# Autodesk Inventor assembly: V6_Engine_Assembly
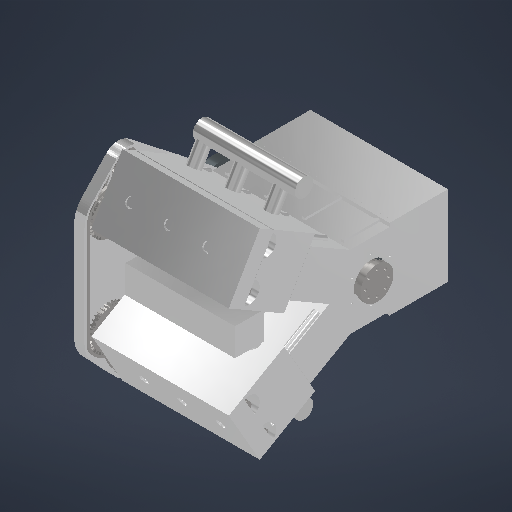
[picture p0: Inventor's stored thumbnail of the model, 512x512]
Saved by Autodesk Inventor 2027.1 (Build 311270010, 270A)
## iProperties
Created: 2026-10-17
Part Number: V6_Engine_Assembly
Document SubType Name: Assembly
Designer: kashyap
Author: kashyap
## Documents named in this file (14)
- C:\Users\kashyap\Documents\V6_2GR\V6_Engine_Assembly.iam
- C:\Users\kashyap\Documents\V6_2GR\V6_Engine_Block.ipt
- C:\Users\kashyap\Documents\V6_2GR\V6_Main_Bearing_Cap.ipt
- C:\Users\kashyap\Documents\V6_2GR\Main_Shell_Upper.ipt
- C:\Users\kashyap\Documents\V6_2GR\Main_Shell_Lower.ipt
- C:\Users\kashyap\Documents\V6_2GR\V6_Crankshaft.ipt
- C:\Users\kashyap\Documents\V6_2GR\Con_Rod.ipt
- C:\Users\kashyap\Documents\V6_2GR\Rod_Cap.ipt
- C:\Users\kashyap\Documents\V6_2GR\Rod_Shell_Upper.ipt
- C:\Users\kashyap\Documents\V6_2GR\Rod_Shell_Lower.ipt
- C:\Users\kashyap\Documents\V6_2GR\Piston.ipt
- C:\Users\kashyap\Documents\V6_2GR\Wrist_Pin.ipt
- C:\Users\kashyap\Documents\V6_2GR\V6_Heads_Valvetrain.iam
- C:\Users\kashyap\Documents\V6_2GR\V6_Externals.iam
## Components (52 placed, 52 different names)
1. Block — Main_Cap_1_Flush_X, Main_Cap_1_Flush_Y, Main_Cap_1_Flush_Z, Main_Shell_Upper_1_Flush_X, Main_Shell_Upper_1_Flush_Y, Main_Shell_Upper_1_Flush_Z, Main_Shell_Lower_1_Flush_X, Main_Shell_Lower_1_Flush_Y, Main_Shell_Lower_1_Flush_Z, Main_Cap_2_Flush_X, Main_Cap_2_Flush_Y, Main_Cap_2_Flush_Z, Main_Shell_Upper_2_Flush_X, Main_Shell_Upper_2_Flush_Y, Main_Shell_Upper_2_Flush_Z, Main_Shell_Lower_2_Flush_X, Main_Shell_Lower_2_Flush_Y, Main_Shell_Lower_2_Flush_Z, Main_Cap_3_Flush_X, Main_Cap_3_Flush_Y, Main_Cap_3_Flush_Z, Main_Shell_Upper_3_Flush_X, Main_Shell_Upper_3_Flush_Y, Main_Shell_Upper_3_Flush_Z, Main_Shell_Lower_3_Flush_X, Main_Shell_Lower_3_Flush_Y, Main_Shell_Lower_3_Flush_Z, Main_Cap_4_Flush_X, Main_Cap_4_Flush_Y, Main_Cap_4_Flush_Z, Main_Shell_Upper_4_Flush_X, Main_Shell_Upper_4_Flush_Y, Main_Shell_Upper_4_Flush_Z, Main_Shell_Lower_4_Flush_X, Main_Shell_Lower_4_Flush_Y, Main_Shell_Lower_4_Flush_Z, Crank_on_Crankshaft_Axis, Crank_Axial_Flush, Crank_Angle_Drive, Piston_A1_on_Cylinder_Axis, Piston_B1_on_Cylinder_Axis, Piston_A2_on_Cylinder_Axis, Piston_B2_on_Cylinder_Axis, Piston_A3_on_Cylinder_Axis, Piston_B3_on_Cylinder_Axis, Heads_Valvetrain_Flush_X, Heads_Valvetrain_Flush_Y, Heads_Valvetrain_Flush_Z, Externals_Flush_X, Externals_Flush_Y, Externals_Flush_Z
2. Main_Cap_1 — Main_Cap_1_Flush_X, Main_Cap_1_Flush_Y, Main_Cap_1_Flush_Z
3. Main_Shell_Upper_1 — Main_Shell_Upper_1_Flush_X, Main_Shell_Upper_1_Flush_Y, Main_Shell_Upper_1_Flush_Z
4. Main_Shell_Lower_1 — Main_Shell_Lower_1_Flush_X, Main_Shell_Lower_1_Flush_Y, Main_Shell_Lower_1_Flush_Z
5. Main_Cap_2 — Main_Cap_2_Flush_X, Main_Cap_2_Flush_Y, Main_Cap_2_Flush_Z
6. Main_Shell_Upper_2 — Main_Shell_Upper_2_Flush_X, Main_Shell_Upper_2_Flush_Y, Main_Shell_Upper_2_Flush_Z
7. Main_Shell_Lower_2 — Main_Shell_Lower_2_Flush_X, Main_Shell_Lower_2_Flush_Y, Main_Shell_Lower_2_Flush_Z
8. Main_Cap_3 — Main_Cap_3_Flush_X, Main_Cap_3_Flush_Y, Main_Cap_3_Flush_Z
9. Main_Shell_Upper_3 — Main_Shell_Upper_3_Flush_X, Main_Shell_Upper_3_Flush_Y, Main_Shell_Upper_3_Flush_Z
10. Main_Shell_Lower_3 — Main_Shell_Lower_3_Flush_X, Main_Shell_Lower_3_Flush_Y, Main_Shell_Lower_3_Flush_Z
11. Main_Cap_4 — Main_Cap_4_Flush_X, Main_Cap_4_Flush_Y, Main_Cap_4_Flush_Z
12. Main_Shell_Upper_4 — Main_Shell_Upper_4_Flush_X, Main_Shell_Upper_4_Flush_Y, Main_Shell_Upper_4_Flush_Z
13. Main_Shell_Lower_4 — Main_Shell_Lower_4_Flush_X, Main_Shell_Lower_4_Flush_Y, Main_Shell_Lower_4_Flush_Z
14. Crankshaft — Crank_on_Crankshaft_Axis, Crank_Axial_Flush, Crank_Angle_Drive, Rod_A1_on_Crankpin, Rod_A1_Mid_Flush, Rod_B1_on_Crankpin, Rod_B1_Mid_Flush, Rod_A2_on_Crankpin, Rod_A2_Mid_Flush, Rod_B2_on_Crankpin, Rod_B2_Mid_Flush, Rod_A3_on_Crankpin, Rod_A3_Mid_Flush, Rod_B3_on_Crankpin, Rod_B3_Mid_Flush
15. Rod_A1 — Rod_A1_on_Crankpin, Rod_A1_Mid_Flush, Rod_A1_SmallEnd_on_Pin_Axis, Rod_Cap_A1_Flush_X, Rod_Cap_A1_Flush_Y, Rod_Cap_A1_Flush_Z, Rod_Shell_Upper_A1_Flush_X, Rod_Shell_Upper_A1_Flush_Y, Rod_Shell_Upper_A1_Flush_Z, Rod_Shell_Lower_A1_Flush_X, Rod_Shell_Lower_A1_Flush_Y, Rod_Shell_Lower_A1_Flush_Z
16. Rod_Cap_A1 — Rod_Cap_A1_Flush_X, Rod_Cap_A1_Flush_Y, Rod_Cap_A1_Flush_Z
17. Rod_Shell_Upper_A1 — Rod_Shell_Upper_A1_Flush_X, Rod_Shell_Upper_A1_Flush_Y, Rod_Shell_Upper_A1_Flush_Z
18. Rod_Shell_Lower_A1 — Rod_Shell_Lower_A1_Flush_X, Rod_Shell_Lower_A1_Flush_Y, Rod_Shell_Lower_A1_Flush_Z
19. Piston_A1 — Piston_A1_on_Cylinder_Axis, Rod_A1_SmallEnd_on_Pin_Axis, Wrist_Pin_A1_Flush_X, Wrist_Pin_A1_Flush_Y, Wrist_Pin_A1_Flush_Z
20. Wrist_Pin_A1 — Wrist_Pin_A1_Flush_X, Wrist_Pin_A1_Flush_Y, Wrist_Pin_A1_Flush_Z
21. Rod_B1 — Rod_B1_on_Crankpin, Rod_B1_Mid_Flush, Rod_B1_SmallEnd_on_Pin_Axis, Rod_Cap_B1_Flush_X, Rod_Cap_B1_Flush_Y, Rod_Cap_B1_Flush_Z, Rod_Shell_Upper_B1_Flush_X, Rod_Shell_Upper_B1_Flush_Y, Rod_Shell_Upper_B1_Flush_Z, Rod_Shell_Lower_B1_Flush_X, Rod_Shell_Lower_B1_Flush_Y, Rod_Shell_Lower_B1_Flush_Z
22. Rod_Cap_B1 — Rod_Cap_B1_Flush_X, Rod_Cap_B1_Flush_Y, Rod_Cap_B1_Flush_Z
23. Rod_Shell_Upper_B1 — Rod_Shell_Upper_B1_Flush_X, Rod_Shell_Upper_B1_Flush_Y, Rod_Shell_Upper_B1_Flush_Z
24. Rod_Shell_Lower_B1 — Rod_Shell_Lower_B1_Flush_X, Rod_Shell_Lower_B1_Flush_Y, Rod_Shell_Lower_B1_Flush_Z
25. Piston_B1 — Piston_B1_on_Cylinder_Axis, Rod_B1_SmallEnd_on_Pin_Axis, Wrist_Pin_B1_Flush_X, Wrist_Pin_B1_Flush_Y, Wrist_Pin_B1_Flush_Z
26. Wrist_Pin_B1 — Wrist_Pin_B1_Flush_X, Wrist_Pin_B1_Flush_Y, Wrist_Pin_B1_Flush_Z
27. Rod_A2 — Rod_A2_on_Crankpin, Rod_A2_Mid_Flush, Rod_A2_SmallEnd_on_Pin_Axis, Rod_Cap_A2_Flush_X, Rod_Cap_A2_Flush_Y, Rod_Cap_A2_Flush_Z, Rod_Shell_Upper_A2_Flush_X, Rod_Shell_Upper_A2_Flush_Y, Rod_Shell_Upper_A2_Flush_Z, Rod_Shell_Lower_A2_Flush_X, Rod_Shell_Lower_A2_Flush_Y, Rod_Shell_Lower_A2_Flush_Z
28. Rod_Cap_A2 — Rod_Cap_A2_Flush_X, Rod_Cap_A2_Flush_Y, Rod_Cap_A2_Flush_Z
29. Rod_Shell_Upper_A2 — Rod_Shell_Upper_A2_Flush_X, Rod_Shell_Upper_A2_Flush_Y, Rod_Shell_Upper_A2_Flush_Z
30. Rod_Shell_Lower_A2 — Rod_Shell_Lower_A2_Flush_X, Rod_Shell_Lower_A2_Flush_Y, Rod_Shell_Lower_A2_Flush_Z
31. Piston_A2 — Piston_A2_on_Cylinder_Axis, Rod_A2_SmallEnd_on_Pin_Axis, Wrist_Pin_A2_Flush_X, Wrist_Pin_A2_Flush_Y, Wrist_Pin_A2_Flush_Z
32. Wrist_Pin_A2 — Wrist_Pin_A2_Flush_X, Wrist_Pin_A2_Flush_Y, Wrist_Pin_A2_Flush_Z
33. Rod_B2 — Rod_B2_on_Crankpin, Rod_B2_Mid_Flush, Rod_B2_SmallEnd_on_Pin_Axis, Rod_Cap_B2_Flush_X, Rod_Cap_B2_Flush_Y, Rod_Cap_B2_Flush_Z, Rod_Shell_Upper_B2_Flush_X, Rod_Shell_Upper_B2_Flush_Y, Rod_Shell_Upper_B2_Flush_Z, Rod_Shell_Lower_B2_Flush_X, Rod_Shell_Lower_B2_Flush_Y, Rod_Shell_Lower_B2_Flush_Z
34. Rod_Cap_B2 — Rod_Cap_B2_Flush_X, Rod_Cap_B2_Flush_Y, Rod_Cap_B2_Flush_Z
35. Rod_Shell_Upper_B2 — Rod_Shell_Upper_B2_Flush_X, Rod_Shell_Upper_B2_Flush_Y, Rod_Shell_Upper_B2_Flush_Z
36. Rod_Shell_Lower_B2 — Rod_Shell_Lower_B2_Flush_X, Rod_Shell_Lower_B2_Flush_Y, Rod_Shell_Lower_B2_Flush_Z
37. Piston_B2 — Piston_B2_on_Cylinder_Axis, Rod_B2_SmallEnd_on_Pin_Axis, Wrist_Pin_B2_Flush_X, Wrist_Pin_B2_Flush_Y, Wrist_Pin_B2_Flush_Z
38. Wrist_Pin_B2 — Wrist_Pin_B2_Flush_X, Wrist_Pin_B2_Flush_Y, Wrist_Pin_B2_Flush_Z
39. Rod_A3 — Rod_A3_on_Crankpin, Rod_A3_Mid_Flush, Rod_A3_SmallEnd_on_Pin_Axis, Rod_Cap_A3_Flush_X, Rod_Cap_A3_Flush_Y, Rod_Cap_A3_Flush_Z, Rod_Shell_Upper_A3_Flush_X, Rod_Shell_Upper_A3_Flush_Y, Rod_Shell_Upper_A3_Flush_Z, Rod_Shell_Lower_A3_Flush_X, Rod_Shell_Lower_A3_Flush_Y, Rod_Shell_Lower_A3_Flush_Z
40. Rod_Cap_A3 — Rod_Cap_A3_Flush_X, Rod_Cap_A3_Flush_Y, Rod_Cap_A3_Flush_Z
41. Rod_Shell_Upper_A3 — Rod_Shell_Upper_A3_Flush_X, Rod_Shell_Upper_A3_Flush_Y, Rod_Shell_Upper_A3_Flush_Z
42. Rod_Shell_Lower_A3 — Rod_Shell_Lower_A3_Flush_X, Rod_Shell_Lower_A3_Flush_Y, Rod_Shell_Lower_A3_Flush_Z
43. Piston_A3 — Piston_A3_on_Cylinder_Axis, Rod_A3_SmallEnd_on_Pin_Axis, Wrist_Pin_A3_Flush_X, Wrist_Pin_A3_Flush_Y, Wrist_Pin_A3_Flush_Z
44. Wrist_Pin_A3 — Wrist_Pin_A3_Flush_X, Wrist_Pin_A3_Flush_Y, Wrist_Pin_A3_Flush_Z
45. Rod_B3 — Rod_B3_on_Crankpin, Rod_B3_Mid_Flush, Rod_B3_SmallEnd_on_Pin_Axis, Rod_Cap_B3_Flush_X, Rod_Cap_B3_Flush_Y, Rod_Cap_B3_Flush_Z, Rod_Shell_Upper_B3_Flush_X, Rod_Shell_Upper_B3_Flush_Y, Rod_Shell_Upper_B3_Flush_Z, Rod_Shell_Lower_B3_Flush_X, Rod_Shell_Lower_B3_Flush_Y, Rod_Shell_Lower_B3_Flush_Z
46. Rod_Cap_B3 — Rod_Cap_B3_Flush_X, Rod_Cap_B3_Flush_Y, Rod_Cap_B3_Flush_Z
47. Rod_Shell_Upper_B3 — Rod_Shell_Upper_B3_Flush_X, Rod_Shell_Upper_B3_Flush_Y, Rod_Shell_Upper_B3_Flush_Z
48. Rod_Shell_Lower_B3 — Rod_Shell_Lower_B3_Flush_X, Rod_Shell_Lower_B3_Flush_Y, Rod_Shell_Lower_B3_Flush_Z
49. Piston_B3 — Piston_B3_on_Cylinder_Axis, Rod_B3_SmallEnd_on_Pin_Axis, Wrist_Pin_B3_Flush_X, Wrist_Pin_B3_Flush_Y, Wrist_Pin_B3_Flush_Z
50. Wrist_Pin_B3 — Wrist_Pin_B3_Flush_X, Wrist_Pin_B3_Flush_Y, Wrist_Pin_B3_Flush_Z
51. Heads_Valvetrain [sub-assembly] — Heads_Valvetrain_Flush_X, Heads_Valvetrain_Flush_Y, Heads_Valvetrain_Flush_Z
52. Externals [sub-assembly] — Externals_Flush_X, Externals_Flush_Y, Externals_Flush_Z
## Relationships (141: Flush 121, Mate 19, Angle 1)
- Main_Cap_1_Flush_X [Flush]: Block ↔ Main_Cap_1
- Main_Cap_1_Flush_Y [Flush]: Block ↔ Main_Cap_1
- Main_Cap_1_Flush_Z [Flush]: Block ↔ Main_Cap_1
- Main_Shell_Upper_1_Flush_X [Flush]: Block ↔ Main_Shell_Upper_1
- Main_Shell_Upper_1_Flush_Y [Flush]: Block ↔ Main_Shell_Upper_1
- Main_Shell_Upper_1_Flush_Z [Flush]: Block ↔ Main_Shell_Upper_1
- Main_Shell_Lower_1_Flush_X [Flush]: Block ↔ Main_Shell_Lower_1
- Main_Shell_Lower_1_Flush_Y [Flush]: Block ↔ Main_Shell_Lower_1
- Main_Shell_Lower_1_Flush_Z [Flush]: Block ↔ Main_Shell_Lower_1
- Main_Cap_2_Flush_X [Flush]: Block ↔ Main_Cap_2
- Main_Cap_2_Flush_Y [Flush]: Block ↔ Main_Cap_2
- Main_Cap_2_Flush_Z [Flush]: Block ↔ Main_Cap_2
- Main_Shell_Upper_2_Flush_X [Flush]: Block ↔ Main_Shell_Upper_2
- Main_Shell_Upper_2_Flush_Y [Flush]: Block ↔ Main_Shell_Upper_2
- Main_Shell_Upper_2_Flush_Z [Flush]: Block ↔ Main_Shell_Upper_2
- Main_Shell_Lower_2_Flush_X [Flush]: Block ↔ Main_Shell_Lower_2
- Main_Shell_Lower_2_Flush_Y [Flush]: Block ↔ Main_Shell_Lower_2
- Main_Shell_Lower_2_Flush_Z [Flush]: Block ↔ Main_Shell_Lower_2
- Main_Cap_3_Flush_X [Flush]: Block ↔ Main_Cap_3
- Main_Cap_3_Flush_Y [Flush]: Block ↔ Main_Cap_3
- Main_Cap_3_Flush_Z [Flush]: Block ↔ Main_Cap_3
- Main_Shell_Upper_3_Flush_X [Flush]: Block ↔ Main_Shell_Upper_3
- Main_Shell_Upper_3_Flush_Y [Flush]: Block ↔ Main_Shell_Upper_3
- Main_Shell_Upper_3_Flush_Z [Flush]: Block ↔ Main_Shell_Upper_3
- Main_Shell_Lower_3_Flush_X [Flush]: Block ↔ Main_Shell_Lower_3
- Main_Shell_Lower_3_Flush_Y [Flush]: Block ↔ Main_Shell_Lower_3
- Main_Shell_Lower_3_Flush_Z [Flush]: Block ↔ Main_Shell_Lower_3
- Main_Cap_4_Flush_X [Flush]: Block ↔ Main_Cap_4
- Main_Cap_4_Flush_Y [Flush]: Block ↔ Main_Cap_4
- Main_Cap_4_Flush_Z [Flush]: Block ↔ Main_Cap_4
- Main_Shell_Upper_4_Flush_X [Flush]: Block ↔ Main_Shell_Upper_4
- Main_Shell_Upper_4_Flush_Y [Flush]: Block ↔ Main_Shell_Upper_4
- Main_Shell_Upper_4_Flush_Z [Flush]: Block ↔ Main_Shell_Upper_4
- Main_Shell_Lower_4_Flush_X [Flush]: Block ↔ Main_Shell_Lower_4
- Main_Shell_Lower_4_Flush_Y [Flush]: Block ↔ Main_Shell_Lower_4
- Main_Shell_Lower_4_Flush_Z [Flush]: Block ↔ Main_Shell_Lower_4
- Crank_on_Crankshaft_Axis [Mate]: Block ↔ Crankshaft
- Crank_Axial_Flush [Flush]: Block ↔ Crankshaft
- Crank_Angle_Drive [Angle] (360 deg): Block ↔ Crankshaft
- Rod_A1_on_Crankpin [Mate]: Crankshaft ↔ Rod_A1
- Rod_A1_Mid_Flush [Flush]: Crankshaft ↔ Rod_A1
- Piston_A1_on_Cylinder_Axis [Mate]: Block ↔ Piston_A1
- Rod_A1_SmallEnd_on_Pin_Axis [Mate]: Rod_A1 ↔ Piston_A1
- Wrist_Pin_A1_Flush_X [Flush]: Piston_A1 ↔ Wrist_Pin_A1
- Wrist_Pin_A1_Flush_Y [Flush]: Piston_A1 ↔ Wrist_Pin_A1
- Wrist_Pin_A1_Flush_Z [Flush]: Piston_A1 ↔ Wrist_Pin_A1
- Rod_Cap_A1_Flush_X [Flush]: Rod_A1 ↔ Rod_Cap_A1
- Rod_Cap_A1_Flush_Y [Flush]: Rod_A1 ↔ Rod_Cap_A1
- Rod_Cap_A1_Flush_Z [Flush]: Rod_A1 ↔ Rod_Cap_A1
- Rod_Shell_Upper_A1_Flush_X [Flush]: Rod_A1 ↔ Rod_Shell_Upper_A1
- Rod_Shell_Upper_A1_Flush_Y [Flush]: Rod_A1 ↔ Rod_Shell_Upper_A1
- Rod_Shell_Upper_A1_Flush_Z [Flush]: Rod_A1 ↔ Rod_Shell_Upper_A1
- Rod_Shell_Lower_A1_Flush_X [Flush]: Rod_A1 ↔ Rod_Shell_Lower_A1
- Rod_Shell_Lower_A1_Flush_Y [Flush]: Rod_A1 ↔ Rod_Shell_Lower_A1
- Rod_Shell_Lower_A1_Flush_Z [Flush]: Rod_A1 ↔ Rod_Shell_Lower_A1
- Rod_B1_on_Crankpin [Mate]: Crankshaft ↔ Rod_B1
- Rod_B1_Mid_Flush [Flush]: Crankshaft ↔ Rod_B1
- Piston_B1_on_Cylinder_Axis [Mate]: Block ↔ Piston_B1
- Rod_B1_SmallEnd_on_Pin_Axis [Mate]: Rod_B1 ↔ Piston_B1
- Wrist_Pin_B1_Flush_X [Flush]: Piston_B1 ↔ Wrist_Pin_B1
- Wrist_Pin_B1_Flush_Y [Flush]: Piston_B1 ↔ Wrist_Pin_B1
- Wrist_Pin_B1_Flush_Z [Flush]: Piston_B1 ↔ Wrist_Pin_B1
- Rod_Cap_B1_Flush_X [Flush]: Rod_B1 ↔ Rod_Cap_B1
- Rod_Cap_B1_Flush_Y [Flush]: Rod_B1 ↔ Rod_Cap_B1
- Rod_Cap_B1_Flush_Z [Flush]: Rod_B1 ↔ Rod_Cap_B1
- Rod_Shell_Upper_B1_Flush_X [Flush]: Rod_B1 ↔ Rod_Shell_Upper_B1
- Rod_Shell_Upper_B1_Flush_Y [Flush]: Rod_B1 ↔ Rod_Shell_Upper_B1
- Rod_Shell_Upper_B1_Flush_Z [Flush]: Rod_B1 ↔ Rod_Shell_Upper_B1
- Rod_Shell_Lower_B1_Flush_X [Flush]: Rod_B1 ↔ Rod_Shell_Lower_B1
- Rod_Shell_Lower_B1_Flush_Y [Flush]: Rod_B1 ↔ Rod_Shell_Lower_B1
- Rod_Shell_Lower_B1_Flush_Z [Flush]: Rod_B1 ↔ Rod_Shell_Lower_B1
- Rod_A2_on_Crankpin [Mate]: Crankshaft ↔ Rod_A2
- Rod_A2_Mid_Flush [Flush]: Crankshaft ↔ Rod_A2
- Piston_A2_on_Cylinder_Axis [Mate]: Block ↔ Piston_A2
- Rod_A2_SmallEnd_on_Pin_Axis [Mate]: Rod_A2 ↔ Piston_A2
- Wrist_Pin_A2_Flush_X [Flush]: Piston_A2 ↔ Wrist_Pin_A2
- Wrist_Pin_A2_Flush_Y [Flush]: Piston_A2 ↔ Wrist_Pin_A2
- Wrist_Pin_A2_Flush_Z [Flush]: Piston_A2 ↔ Wrist_Pin_A2
- Rod_Cap_A2_Flush_X [Flush]: Rod_A2 ↔ Rod_Cap_A2
- Rod_Cap_A2_Flush_Y [Flush]: Rod_A2 ↔ Rod_Cap_A2
- Rod_Cap_A2_Flush_Z [Flush]: Rod_A2 ↔ Rod_Cap_A2
- Rod_Shell_Upper_A2_Flush_X [Flush]: Rod_A2 ↔ Rod_Shell_Upper_A2
- Rod_Shell_Upper_A2_Flush_Y [Flush]: Rod_A2 ↔ Rod_Shell_Upper_A2
- Rod_Shell_Upper_A2_Flush_Z [Flush]: Rod_A2 ↔ Rod_Shell_Upper_A2
- Rod_Shell_Lower_A2_Flush_X [Flush]: Rod_A2 ↔ Rod_Shell_Lower_A2
- Rod_Shell_Lower_A2_Flush_Y [Flush]: Rod_A2 ↔ Rod_Shell_Lower_A2
- Rod_Shell_Lower_A2_Flush_Z [Flush]: Rod_A2 ↔ Rod_Shell_Lower_A2
- Rod_B2_on_Crankpin [Mate]: Crankshaft ↔ Rod_B2
- Rod_B2_Mid_Flush [Flush]: Crankshaft ↔ Rod_B2
- Piston_B2_on_Cylinder_Axis [Mate]: Block ↔ Piston_B2
- Rod_B2_SmallEnd_on_Pin_Axis [Mate]: Rod_B2 ↔ Piston_B2
- Wrist_Pin_B2_Flush_X [Flush]: Piston_B2 ↔ Wrist_Pin_B2
- Wrist_Pin_B2_Flush_Y [Flush]: Piston_B2 ↔ Wrist_Pin_B2
- Wrist_Pin_B2_Flush_Z [Flush]: Piston_B2 ↔ Wrist_Pin_B2
- Rod_Cap_B2_Flush_X [Flush]: Rod_B2 ↔ Rod_Cap_B2
- Rod_Cap_B2_Flush_Y [Flush]: Rod_B2 ↔ Rod_Cap_B2
- Rod_Cap_B2_Flush_Z [Flush]: Rod_B2 ↔ Rod_Cap_B2
- Rod_Shell_Upper_B2_Flush_X [Flush]: Rod_B2 ↔ Rod_Shell_Upper_B2
- Rod_Shell_Upper_B2_Flush_Y [Flush]: Rod_B2 ↔ Rod_Shell_Upper_B2
- Rod_Shell_Upper_B2_Flush_Z [Flush]: Rod_B2 ↔ Rod_Shell_Upper_B2
- Rod_Shell_Lower_B2_Flush_X [Flush]: Rod_B2 ↔ Rod_Shell_Lower_B2
- Rod_Shell_Lower_B2_Flush_Y [Flush]: Rod_B2 ↔ Rod_Shell_Lower_B2
- Rod_Shell_Lower_B2_Flush_Z [Flush]: Rod_B2 ↔ Rod_Shell_Lower_B2
- Rod_A3_on_Crankpin [Mate]: Crankshaft ↔ Rod_A3
- Rod_A3_Mid_Flush [Flush]: Crankshaft ↔ Rod_A3
- Piston_A3_on_Cylinder_Axis [Mate]: Block ↔ Piston_A3
- Rod_A3_SmallEnd_on_Pin_Axis [Mate]: Rod_A3 ↔ Piston_A3
- Wrist_Pin_A3_Flush_X [Flush]: Piston_A3 ↔ Wrist_Pin_A3
- Wrist_Pin_A3_Flush_Y [Flush]: Piston_A3 ↔ Wrist_Pin_A3
- Wrist_Pin_A3_Flush_Z [Flush]: Piston_A3 ↔ Wrist_Pin_A3
- Rod_Cap_A3_Flush_X [Flush]: Rod_A3 ↔ Rod_Cap_A3
- Rod_Cap_A3_Flush_Y [Flush]: Rod_A3 ↔ Rod_Cap_A3
- Rod_Cap_A3_Flush_Z [Flush]: Rod_A3 ↔ Rod_Cap_A3
- Rod_Shell_Upper_A3_Flush_X [Flush]: Rod_A3 ↔ Rod_Shell_Upper_A3
- Rod_Shell_Upper_A3_Flush_Y [Flush]: Rod_A3 ↔ Rod_Shell_Upper_A3
- Rod_Shell_Upper_A3_Flush_Z [Flush]: Rod_A3 ↔ Rod_Shell_Upper_A3
- Rod_Shell_Lower_A3_Flush_X [Flush]: Rod_A3 ↔ Rod_Shell_Lower_A3
- Rod_Shell_Lower_A3_Flush_Y [Flush]: Rod_A3 ↔ Rod_Shell_Lower_A3
- Rod_Shell_Lower_A3_Flush_Z [Flush]: Rod_A3 ↔ Rod_Shell_Lower_A3
- Rod_B3_on_Crankpin [Mate]: Crankshaft ↔ Rod_B3
- Rod_B3_Mid_Flush [Flush]: Crankshaft ↔ Rod_B3
- Piston_B3_on_Cylinder_Axis [Mate]: Block ↔ Piston_B3
- Rod_B3_SmallEnd_on_Pin_Axis [Mate]: Rod_B3 ↔ Piston_B3
- Wrist_Pin_B3_Flush_X [Flush]: Piston_B3 ↔ Wrist_Pin_B3
- Wrist_Pin_B3_Flush_Y [Flush]: Piston_B3 ↔ Wrist_Pin_B3
- Wrist_Pin_B3_Flush_Z [Flush]: Piston_B3 ↔ Wrist_Pin_B3
- Rod_Cap_B3_Flush_X [Flush]: Rod_B3 ↔ Rod_Cap_B3
- Rod_Cap_B3_Flush_Y [Flush]: Rod_B3 ↔ Rod_Cap_B3
- Rod_Cap_B3_Flush_Z [Flush]: Rod_B3 ↔ Rod_Cap_B3
- Rod_Shell_Upper_B3_Flush_X [Flush]: Rod_B3 ↔ Rod_Shell_Upper_B3
- Rod_Shell_Upper_B3_Flush_Y [Flush]: Rod_B3 ↔ Rod_Shell_Upper_B3
- Rod_Shell_Upper_B3_Flush_Z [Flush]: Rod_B3 ↔ Rod_Shell_Upper_B3
- Rod_Shell_Lower_B3_Flush_X [Flush]: Rod_B3 ↔ Rod_Shell_Lower_B3
- Rod_Shell_Lower_B3_Flush_Y [Flush]: Rod_B3 ↔ Rod_Shell_Lower_B3
- Rod_Shell_Lower_B3_Flush_Z [Flush]: Rod_B3 ↔ Rod_Shell_Lower_B3
- Heads_Valvetrain_Flush_X [Flush]: Block ↔ Heads_Valvetrain
- Heads_Valvetrain_Flush_Y [Flush]: Block ↔ Heads_Valvetrain
- Heads_Valvetrain_Flush_Z [Flush]: Block ↔ Heads_Valvetrain
- Externals_Flush_X [Flush]: Block ↔ Externals
- Externals_Flush_Y [Flush]: Block ↔ Externals
- Externals_Flush_Z [Flush]: Block ↔ Externals
## Named parameters: Crank_Angle = 0 deg
